# Autodesk Inventor assembly: COTS_GlareOne_A-275_Tripod_Exteneded_Shorter
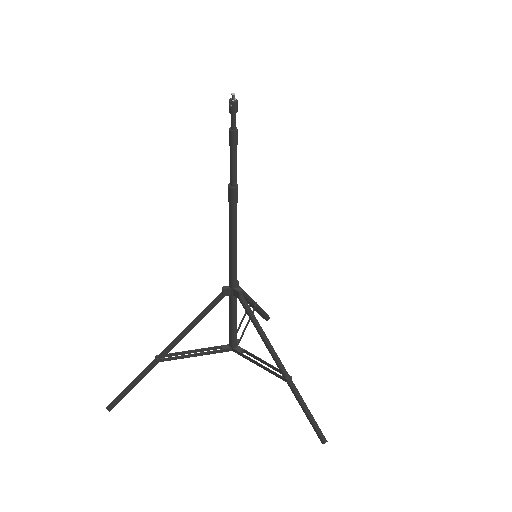
[picture p0: Inventor's stored thumbnail of the model, 512x512]
Saved by Autodesk Inventor 2027 (Build 310192060, 192F)
## iProperties
Created: 2025-05-09
Part Number: COTS_GlareOne_A-275_Tripod_Exteneded_Shorter
Document SubType Name: Assembly
Designer: User
Author: User
## Documents named in this file (5)
- C:\Users\lacze\OneDrive\_DRIVE_SYNCH_FILES\RF - Antenna Positioner\MCAD\1_V1\__COTS_PARTS\COTS_GlareOne_A-275_Tripod\COTS_GlareOne_A-275_Tripod_Exteneded_Shorter.iam
- C:\Users\lacze\OneDrive\_DRIVE_SYNCH_FILES\RF - Antenna Positioner\MCAD\1_V1\__COTS_PARTS\COTS_GlareOne_A-275_Tripod\COTS_GlareOne_A-275_Tripod_Base.ipt
- C:\Users\lacze\OneDrive\_DRIVE_SYNCH_FILES\RF - Antenna Positioner\MCAD\1_V1\__COTS_PARTS\COTS_GlareOne_A-275_Tripod\COTS_GlareOne_A-275_Tripod_1st_telescopic_section.ipt
- C:\Users\lacze\OneDrive\_DRIVE_SYNCH_FILES\RF - Antenna Positioner\MCAD\1_V1\__COTS_PARTS\COTS_GlareOne_A-275_Tripod\COTS_GlareOne_A-275_Tripod_2nd_telescopic_section.ipt
- C:\Users\lacze\OneDrive\_DRIVE_SYNCH_FILES\RF - Antenna Positioner\MCAD\1_V1\__COTS_PARTS\COTS_GlareOne_A-275_Tripod\COTS_GlareOne_A-275_Tripod_Mounting_Shaft.ipt
## Components (4 placed, 4 different names)
1. COTS_GlareOne_A-275_Tripod_Base:1 — Mate:1, Mate:2
2. COTS_GlareOne_A-275_Tripod_1st_telescopic_section:1 — Mate:1, Mate:2, Mate:3, Mate:4
3. COTS_GlareOne_A-275_Tripod_2nd_telescopic_section:1 — Mate:3, Mate:4, Mate:5, Mate:6
4. COTS_GlareOne_A-275_Tripod_Mounting_Shaft:1 — Mate:5, Mate:6
## Relationships (6: Mate 6)
- Mate:1: COTS_GlareOne_A-275_Tripod_Base:1 ↔ COTS_GlareOne_A-275_Tripod_1st_telescopic_section:1
- Mate:2 (180 mm): COTS_GlareOne_A-275_Tripod_Base:1 ↔ COTS_GlareOne_A-275_Tripod_1st_telescopic_section:1
- Mate:3: COTS_GlareOne_A-275_Tripod_1st_telescopic_section:1 ↔ COTS_GlareOne_A-275_Tripod_2nd_telescopic_section:1
- Mate:4 (76 mm): COTS_GlareOne_A-275_Tripod_1st_telescopic_section:1 ↔ COTS_GlareOne_A-275_Tripod_2nd_telescopic_section:1
- Mate:5: COTS_GlareOne_A-275_Tripod_2nd_telescopic_section:1 ↔ COTS_GlareOne_A-275_Tripod_Mounting_Shaft:1
- Mate:6: COTS_GlareOne_A-275_Tripod_2nd_telescopic_section:1 ↔ COTS_GlareOne_A-275_Tripod_Mounting_Shaft:1
